# Autodesk Inventor assembly: BaseCalibracion
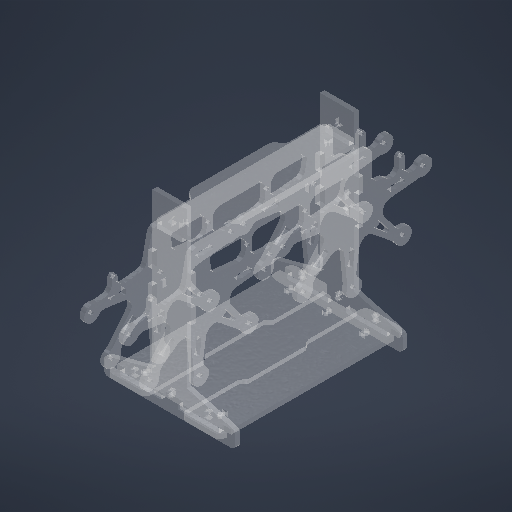
[picture p0: Inventor's stored thumbnail of the model, 512x512]
Saved by Autodesk Inventor 2027.1 (Build 311270010, 270A)
## iProperties
Created: 2026-11-02
Part Number: BaseCalibracion
Document SubType Name: Assembly
Designer: Cris
Author: Cris
## Documents named in this file (7)
- C:\Users\Cris\Desktop\Proyectos Alex\Diseño e Innovación\BaseCalibracionBittle\BaseCalibracion.iam
- C:\Users\Cris\Desktop\Proyectos Alex\Diseño e Innovación\BaseCalibracionBittle\SoportesLaterales.ipt
- C:\Users\Cris\Desktop\Proyectos Alex\Diseño e Innovación\BaseCalibracionBittle\UnionExternaBase.ipt
- C:\Users\Cris\Desktop\Proyectos Alex\Diseño e Innovación\BaseCalibracionBittle\UnionIntermediaBase.ipt
- C:\Users\Cris\Desktop\Proyectos Alex\Diseño e Innovación\BaseCalibracionBittle\UnionSuperiorSoportesLaterales.ipt
- C:\Users\Cris\Desktop\Proyectos Alex\Diseño e Innovación\BaseCalibracionBittle\ReferenciasCalibracion.ipt
- C:\Users\Cris\Desktop\Proyectos Alex\Diseño e Innovación\BaseCalibracionBittle\ReferenciasCalibracionComplemento.ipt
## Components (8 placed, 6 different names)
1. SoportesLaterales:1 — Flush:1, Flush:2, Flush:3, Mate:1, Mate:2, Mate:5, Mate:6, Mate:7, Mate:8, Mate:10, Mate:14, Mate:15, Mate:16, Mate:17, Mate:19, Mate:20, Mate:21
2. SoportesLaterales:2 — Flush:1, Flush:2, Flush:3, Mate:3, Mate:4, Mate:9, Mate:11, Mate:12, Mate:13, Mate:18
3. UnionExternaBase:1 — Mate:2, Mate:4, Mate:6, Mate:8
4. UnionExternaBase:2 — Mate:1, Mate:3, Mate:5, Mate:7, Mate:9
5. UnionIntermediaBase:1 — Mate:10, Mate:11, Mate:12
6. UnionSuperiorSoportesLaterales:1 — Mate:13, Mate:14, Mate:15
7. ReferenciasCalibracion:1 — Mate:16, Mate:17, Mate:18
8. ReferenciasCalibracionComplemento:1 — Mate:19, Mate:20, Mate:21
## Relationships (24: Mate 21, Flush 3)
- Flush:1: SoportesLaterales:1 ↔ SoportesLaterales:2
- Flush:2: SoportesLaterales:1 ↔ SoportesLaterales:2
- Flush:3: SoportesLaterales:1 ↔ SoportesLaterales:2
- Mate:1: SoportesLaterales:1 ↔ UnionExternaBase:2
- Mate:2: SoportesLaterales:1 ↔ UnionExternaBase:1
- Mate:3: SoportesLaterales:2 ↔ UnionExternaBase:2
- Mate:4: SoportesLaterales:2 ↔ UnionExternaBase:1
- Mate:5: SoportesLaterales:1 ↔ UnionExternaBase:2
- Mate:6: SoportesLaterales:1 ↔ UnionExternaBase:1
- Mate:7: SoportesLaterales:1 ↔ UnionExternaBase:2
- Mate:8: SoportesLaterales:1 ↔ UnionExternaBase:1
- Mate:9: SoportesLaterales:2 ↔ UnionExternaBase:2
- Mate:10: SoportesLaterales:1 ↔ UnionIntermediaBase:1
- Mate:11: SoportesLaterales:2 ↔ UnionIntermediaBase:1
- Mate:12: SoportesLaterales:2 ↔ UnionIntermediaBase:1
- Mate:13: SoportesLaterales:2 ↔ UnionSuperiorSoportesLaterales:1
- Mate:14: SoportesLaterales:1 ↔ UnionSuperiorSoportesLaterales:1
- Mate:15: SoportesLaterales:1 ↔ UnionSuperiorSoportesLaterales:1
- Mate:16: SoportesLaterales:1 ↔ ReferenciasCalibracion:1
- Mate:17: SoportesLaterales:1 ↔ ReferenciasCalibracion:1
- Mate:18: SoportesLaterales:2 ↔ ReferenciasCalibracion:1
- Mate:19: SoportesLaterales:1 ↔ ReferenciasCalibracionComplemento:1
- Mate:20: SoportesLaterales:1 ↔ ReferenciasCalibracionComplemento:1
- Mate:21: SoportesLaterales:1 ↔ ReferenciasCalibracionComplemento:1
